# Autodesk Inventor assembly: V6_Externals
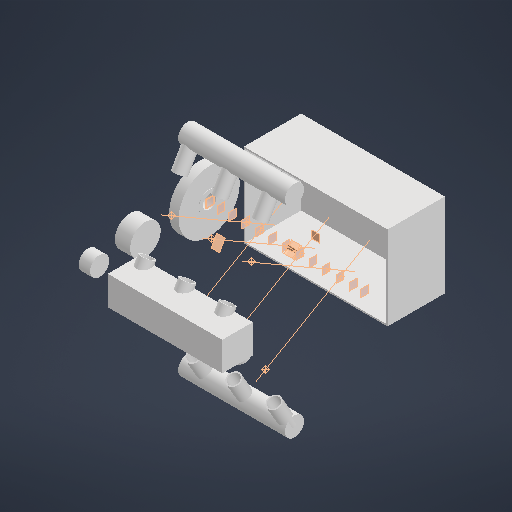
[picture p0: Inventor's stored thumbnail of the model, 512x512]
Saved by Autodesk Inventor 2027.1 (Build 311270010, 270A)
## iProperties
Created: 2026-10-17
Part Number: V6_Externals
Document SubType Name: Assembly
Designer: kashyap
Author: kashyap
## Documents named in this file (7)
- C:\Users\kashyap\Documents\V6_2GR\V6_Externals.iam
- C:\Users\kashyap\Documents\V6_2GR\Oil_Pan_SIMPLIFIED.ipt
- C:\Users\kashyap\Documents\V6_2GR\Crank_Pulley_SIMPLIFIED.ipt
- C:\Users\kashyap\Documents\V6_2GR\Intake_Manifold_SIMPLIFIED.ipt
- C:\Users\kashyap\Documents\V6_2GR\Exhaust_Manifold_A_SIMPLIFIED.ipt
- C:\Users\kashyap\Documents\V6_2GR\Exhaust_Manifold_B_SIMPLIFIED.ipt
- C:\Users\kashyap\Documents\V6_2GR\Water_Pump_Thermostat_SIMPLIFIED.ipt
## Components (6 placed, 6 different names)
1. Oil_Pan_SIMPLIFIED — Oil_Pan_SIMPLIFIED_Flush_X, Oil_Pan_SIMPLIFIED_Flush_Y, Oil_Pan_SIMPLIFIED_Flush_Z
2. Crank_Pulley_SIMPLIFIED — Crank_Pulley_SIMPLIFIED_Flush_X, Crank_Pulley_SIMPLIFIED_Flush_Y, Crank_Pulley_SIMPLIFIED_Flush_Z
3. Intake_Manifold_SIMPLIFIED — Intake_Manifold_SIMPLIFIED_Flush_X, Intake_Manifold_SIMPLIFIED_Flush_Y, Intake_Manifold_SIMPLIFIED_Flush_Z
4. Exhaust_Manifold_A_SIMPLIFIED — Exhaust_Manifold_A_SIMPLIFIED_Flush_X, Exhaust_Manifold_A_SIMPLIFIED_Flush_Y, Exhaust_Manifold_A_SIMPLIFIED_Flush_Z
5. Exhaust_Manifold_B_SIMPLIFIED — Exhaust_Manifold_B_SIMPLIFIED_Flush_X, Exhaust_Manifold_B_SIMPLIFIED_Flush_Y, Exhaust_Manifold_B_SIMPLIFIED_Flush_Z
6. Water_Pump_Thermostat_SIMPLIFIED — Water_Pump_Thermostat_SIMPLIFIED_Flush_X, Water_Pump_Thermostat_SIMPLIFIED_Flush_Y, Water_Pump_Thermostat_SIMPLIFIED_Flush_Z
## Relationships (18: Flush 18)
- Oil_Pan_SIMPLIFIED_Flush_X [Flush]: Oil_Pan_SIMPLIFIED
- Oil_Pan_SIMPLIFIED_Flush_Y [Flush]: Oil_Pan_SIMPLIFIED
- Oil_Pan_SIMPLIFIED_Flush_Z [Flush]: Oil_Pan_SIMPLIFIED
- Crank_Pulley_SIMPLIFIED_Flush_X [Flush]: Crank_Pulley_SIMPLIFIED
- Crank_Pulley_SIMPLIFIED_Flush_Y [Flush]: Crank_Pulley_SIMPLIFIED
- Crank_Pulley_SIMPLIFIED_Flush_Z [Flush]: Crank_Pulley_SIMPLIFIED
- Intake_Manifold_SIMPLIFIED_Flush_X [Flush]: Intake_Manifold_SIMPLIFIED
- Intake_Manifold_SIMPLIFIED_Flush_Y [Flush]: Intake_Manifold_SIMPLIFIED
- Intake_Manifold_SIMPLIFIED_Flush_Z [Flush]: Intake_Manifold_SIMPLIFIED
- Exhaust_Manifold_A_SIMPLIFIED_Flush_X [Flush]: Exhaust_Manifold_A_SIMPLIFIED
- Exhaust_Manifold_A_SIMPLIFIED_Flush_Y [Flush]: Exhaust_Manifold_A_SIMPLIFIED
- Exhaust_Manifold_A_SIMPLIFIED_Flush_Z [Flush]: Exhaust_Manifold_A_SIMPLIFIED
- Exhaust_Manifold_B_SIMPLIFIED_Flush_X [Flush]: Exhaust_Manifold_B_SIMPLIFIED
- Exhaust_Manifold_B_SIMPLIFIED_Flush_Y [Flush]: Exhaust_Manifold_B_SIMPLIFIED
- Exhaust_Manifold_B_SIMPLIFIED_Flush_Z [Flush]: Exhaust_Manifold_B_SIMPLIFIED
- Water_Pump_Thermostat_SIMPLIFIED_Flush_X [Flush]: Water_Pump_Thermostat_SIMPLIFIED
- Water_Pump_Thermostat_SIMPLIFIED_Flush_Y [Flush]: Water_Pump_Thermostat_SIMPLIFIED
- Water_Pump_Thermostat_SIMPLIFIED_Flush_Z [Flush]: Water_Pump_Thermostat_SIMPLIFIED
